# Autodesk Inventor assembly: MM0861AN200_G22_913
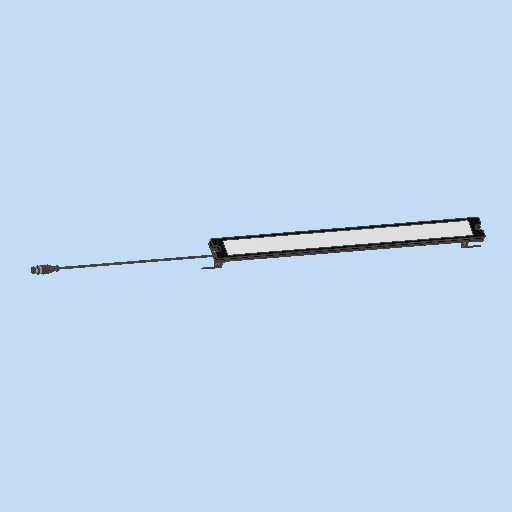
[picture p0: Inventor's stored thumbnail of the model, 512x512]
Saved by Autodesk Inventor 2023.3 (Build 273359000, 359)
## iProperties
RuleStatus: InUse
Created: 2021-05-11
Part Number: MM0861AN200_G22_913
Description: =<RBPARTNOTITLE2>
Document SubType Name: Assembly
Designer: frt9bw
Mass: 247.083 g
Surface Area: 658.378 cm^2
Volume: 203.155 cm^3
Density: 1.21623 g/cm^3
AnP_Material: =<Material>
AnP_TemplVers: 20200821
RBDOCUMENTTYPE: DRF
RBDOCUMENTVERSION: 00
RBDRAWINGMAINSCALE: 1:1
RBDRAWINGMISSINGSPEC: --
RBDRAWINGVOLUME: --
RBDSV1: 0850
RBGBEDGESIN1: +0,5
RBGBEDGESIN2: +0,2
RBGBEDGESOUT1: -0,3
RBGBEDGESOUT2: -0,1
RBMATERIAL: =<Material>
RBMATMEETS: --
RBMATNO: =<Part Number>
RBPARTMADEOF: --
RBPARTNO: SIEHE MNR
RBPARTNOTITLE1: --
RBPARTSAFETYINDICATOR: --
RBSURFACE: --
RBSURFACE2: --
RBZEDGESNORM: ISO13715:2002-06
RBZGENDIMCLASS: m
RBZGENDIMNORM: ISO 2768-1:1989-11
RBZGENGEOCLASS: H
RBZGENGEONORM: ISO 2768-2:1989-11
RBZSURFACENORM: ISO13D2:2002-02
RBZTOLERANCENORM: ISO 14405-1:2010-12
Author: frt9bw
Keywords: =<RBPARTMADEOF>
Comments: =<RBSURFACE2>
Revision Number: 01
## Documents named in this file (4)
- C:\Users\rea9an\Documents\Inventor\TCAI2412_te1910_EM\AS00000899.iam
- C:\Users\rea9an\Documents\Inventor\TCAI2412_te1910_EM\PT00004471.ipt
- C:\Users\rea9an\Documents\Inventor\TCAI2412_te1910_EM\PT00004470.ipt
- C:\Users\rea9an\Documents\Inventor\TCAI2412_te1910_EM\PT00004482.ipt
## Components (5 placed, 3 different names)
1. PT00004471:1 — Passend:1, Fluchtend:1, Fluchtend:2, Einfügen:1
2. PT00004471:2 — Passend:1, Fluchtend:1, Fluchtend:2, Einfügen:2
3. PT00004470:1 — Einfügen:2, Passend:3, Passend:4
4. PT00004470:2 — Einfügen:1, Passend:2, Fluchtend:3
5. PT00004482:1 — Passend:2, Passend:3, Passend:4, Fluchtend:3
## Relationships (9: Mate 4, Flush 3, Insert 2)
- Passend:1 [Mate] (440 mm): PT00004471:1 ↔ PT00004471:2
- Fluchtend:1 [Flush]: PT00004471:1 ↔ PT00004471:2
- Fluchtend:2 [Flush]: PT00004471:1 ↔ PT00004471:2
- Einfügen:1 [Insert] (1.5 mm): PT00004471:1 ↔ PT00004470:2
- Einfügen:2 [Insert]: PT00004471:2 ↔ PT00004470:1
- Passend:2 [Mate]: PT00004470:2 ↔ PT00004482:1
- Passend:3 [Mate]: PT00004470:1 ↔ PT00004482:1
- Passend:4 [Mate] (-40 mm): PT00004470:1 ↔ PT00004482:1
- Fluchtend:3 [Flush]: PT00004470:2 ↔ PT00004482:1
